# Autodesk Inventor assembly: MM0948AN140_G00_801
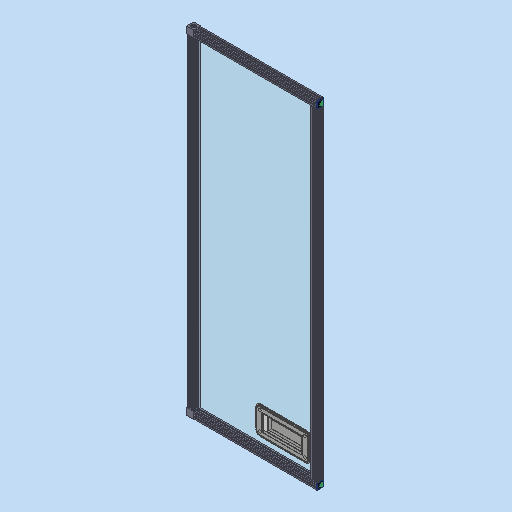
[picture p0: Inventor's stored thumbnail of the model, 512x512]
Saved by Autodesk Inventor 2023.3 (Build 273359000, 359)
## iProperties
Created: 2023-03-23
Part Number: MM0948AN140_G00_801
Description: =<RBPARTNOTITLE2>
Document SubType Name: Assembly
Designer: FH/Wi
Mass: 2262.51 g
Surface Area: 11304 cm^2
Volume: 1369.2 cm^3
Density: 1.65243 g/cm^3
AnP_Kategorie: 98
AnP_Material: =<Material>
AnP_TemplVers: 20200821
RBDOCUMENTTYPE: DRF
RBDOCUMENTVERSION: 00
RBDRAWINGMAINSCALE: 1:1
RBDRAWINGMISSINGSPEC: --
RBDRAWINGVOLUME: --
RBDSV1: 0850
RBGBEDGESIN1: +0,5
RBGBEDGESIN2: +0,2
RBGBEDGESOUT1: -0,3
RBGBEDGESOUT2: -0,1
RBMATERIAL: =<Material>
RBMATMEETS: --
RBMATNO: =<Part Number>
RBPARTMADEOF: --
RBPARTNO: SIEHE MNR
RBPARTNOTITLE1: enter description here
RBPARTNOTITLE2: hier Bezeichnung eintragen
RBPARTSAFETYINDICATOR: --
RBSURFACE: --
RBSURFACE2: --
RBZEDGESNORM: ISO13715:2002-06
RBZGENDIMCLASS: m
RBZGENDIMNORM: ISO 2768-1:1989-11
RBZGENGEOCLASS: H
RBZGENGEONORM: ISO 2768-2:1989-11
RBZSURFACENORM: ISO13D2:2002-02
RBZTOLERANCENORM: ISO 14405-1:2010-12
Author: FH/Wi
Keywords: =<RBPARTMADEOF>
Comments: =<RBSURFACE2>
Revision Number: 01
## Documents named in this file (8)
- C:\Users\rea9an\Documents\Inventor\TCAI2412_te1910_EM\AS00000951.iam
- C:\Users\rea9an\Documents\Inventor\TCAI2412_te1910_EM\PT00004319.ipt
- C:\Users\rea9an\Documents\Inventor\TCAI2412_te1910_EM\PT00004665.ipt
- C:\Users\rea9an\Documents\Inventor\TCAI2412_te1910_EM\PT00004405.ipt
- C:\Users\rea9an\Documents\Inventor\TCAI2412_te1910_EM\PT00004819.ipt
- C:\Users\rea9an\Documents\Inventor\TCAI2412_te1910_EM\PT00004340.ipt
- C:\Users\rea9an\Documents\Inventor\TCAI2412_te1910_EM\PT00004321.ipt
- C:\Users\rea9an\Documents\Inventor\TCAI2412_te1910_EM\PT00004343.ipt
## Components (14 placed, 7 different names)
1. PT00004665:1 — Passend:20, Passend:21, Passend:33
2. PT00004405:1 — Passend:20, Passend:21
3. PT00004343:1
4. PT00004343:2
5. PT00004340:1 — Fluchtend:19
6. PT00004340:2 — Passend:30, Fluchtend:15, Fluchtend:16, Passend:33, Passend:34, Fluchtend:20, Fluchtend:21
7. PT00004319:1
8. PT00004321:1 — Passend:34, Fluchtend:20, Fluchtend:21
9. PT00004319:2 — Fluchtend:19
10. PT00004321:2 — Passend:30, Fluchtend:15, Fluchtend:16
11. PT00004819:1
12. PT00004819:2
13. PT00004819:3
14. PT00004819:4
## Relationships (31: Mate 15, Flush 10, Insert 4, Angle 2)
- [Mate]: PT00004343:1 ↔ PT00004319:1
- [Mate]: PT00004665:1 ↔ PT00004405:1
- [Mate]: PT00004343:1 ↔ PT00004321:1
- [Mate]: PT00004343:2 ↔ PT00004319:2
- [Flush]: PT00004665:1 ↔ PT00004340:2
- [Insert]: PT00004665:1 ↔ PT00004819:1
- [Insert]: PT00004665:1 ↔ PT00004819:4
- [Insert]: PT00004665:1 ↔ PT00004819:2
- [Insert]: PT00004665:1 ↔ PT00004819:3
- Passend:20 [Mate]: PT00004665:1 ↔ PT00004405:1
- Passend:21 [Mate]: PT00004665:1 ↔ PT00004405:1
- [Mate]: PT00004343:2 ↔ PT00004340:2
- [Mate] (2 mm): PT00004665:1 ↔ PT00004343:2
- [Flush]: PT00004343:1 ↔ PT00004321:1
- [Flush]: PT00004343:1 ↔ PT00004321:1
- [Mate]: PT00004343:1 ↔ PT00004319:1
- [Angle] (0 deg): PT00004343:1 ↔ PT00004319:1
- [Mate]: PT00004343:2 ↔ PT00004319:2
- [Angle] (0 deg): PT00004343:2 ↔ PT00004319:2
- Passend:30 [Mate]: PT00004340:2 ↔ PT00004321:2
- Fluchtend:15 [Flush]: PT00004340:2 ↔ PT00004321:2
- Fluchtend:16 [Flush]: PT00004340:2 ↔ PT00004321:2
- [Mate]: PT00004343:2 ↔ PT00004321:2
- [Flush]: PT00004343:2 ↔ PT00004321:2
- [Flush]: PT00004343:2 ↔ PT00004340:1
- [Mate]: PT00004343:2 ↔ PT00004340:1
- Fluchtend:19 [Flush]: PT00004340:1 ↔ PT00004319:2
- Passend:33 [Mate] (2 mm): PT00004665:1 ↔ PT00004340:2
- Passend:34 [Mate]: PT00004340:2 ↔ PT00004321:1
- Fluchtend:20 [Flush]: PT00004340:2 ↔ PT00004321:1
- Fluchtend:21 [Flush]: PT00004340:2 ↔ PT00004321:1
## Named parameters: d279_d170 = 0 mm
